# Autodesk Inventor assembly: Assembly V2.1
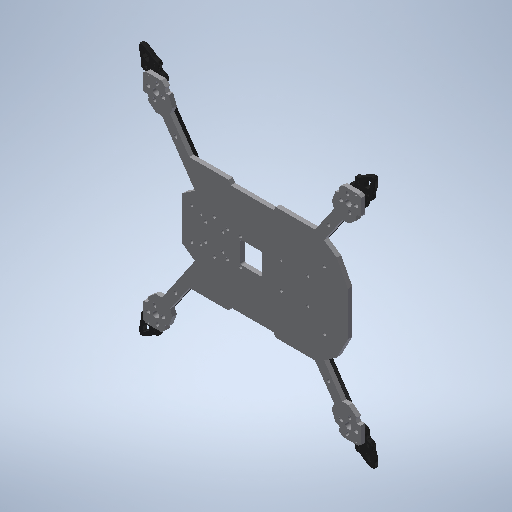
[picture p0: Inventor's stored thumbnail of the model, 512x512]
Saved by Autodesk Inventor 2025.2 (Build 292293000, 293)
## iProperties
Created: 2026-07-10
Part Number: Assembly V2.1
Document SubType Name: Assembly
Designer: crazi
Author: crazi
## Documents named in this file (6)
- D:\Family\Arav\Projects\Drone\Chassis\Custom Chassis\Modelled\Assembly V2.1.iam
- D:\Family\Arav\Projects\Drone\Chassis\Custom Chassis\Modelled\Base Model Split\GEPRC Mk4 7in Arm1.ipt
- D:\Family\Arav\Projects\Drone\Chassis\Custom Chassis\Modelled\Base Model Split\GEPRC Mk4 7in Arm2.ipt
- D:\Family\Arav\Projects\Drone\Chassis\Custom Chassis\Modelled\Base Model Split\GEPRC Mk4 7in Arm3.ipt
- D:\Family\Arav\Projects\Drone\Chassis\Custom Chassis\Modelled\Base Model Split\GEPRC Mk4 7in Arm4.ipt
- D:\Family\Arav\Projects\Drone\Chassis\Custom Chassis\Modelled\Base Model V2.ipt
## Components (5 placed, 5 different names)
1. GEPRC Mk4 7in Arm1:1 — Angle:1, Mate:2, Mate:9
2. GEPRC Mk4 7in Arm2:1 — Mate:4, Angle:2, Mate:10
3. GEPRC Mk4 7in Arm3:1 — Mate:6, Angle:3, Mate:12
4. GEPRC Mk4 7in Arm4:1 — Mate:8, Angle:4, Mate:11
5. Base Model V2:1 — Angle:1, Mate:2, Mate:4, Angle:2, Mate:6, Angle:3, Mate:8, Angle:4, Mate:9, Mate:10, Mate:11, Mate:12
## Relationships (12: Mate 8, Angle 4)
- Angle:1 (0 deg): GEPRC Mk4 7in Arm1:1 ↔ Base Model V2:1
- Mate:2: GEPRC Mk4 7in Arm1:1 ↔ Base Model V2:1
- Mate:4: GEPRC Mk4 7in Arm2:1 ↔ Base Model V2:1
- Angle:2 (0 deg): GEPRC Mk4 7in Arm2:1 ↔ Base Model V2:1
- Mate:6: GEPRC Mk4 7in Arm3:1 ↔ Base Model V2:1
- Angle:3 (0 deg): GEPRC Mk4 7in Arm3:1 ↔ Base Model V2:1
- Mate:8: GEPRC Mk4 7in Arm4:1 ↔ Base Model V2:1
- Angle:4 (0 deg): GEPRC Mk4 7in Arm4:1 ↔ Base Model V2:1
- Mate:9: GEPRC Mk4 7in Arm1:1 ↔ Base Model V2:1
- Mate:10: GEPRC Mk4 7in Arm2:1 ↔ Base Model V2:1
- Mate:11: GEPRC Mk4 7in Arm4:1 ↔ Base Model V2:1
- Mate:12: GEPRC Mk4 7in Arm3:1 ↔ Base Model V2:1
